# Autodesk Inventor assembly: mate-sub-pin
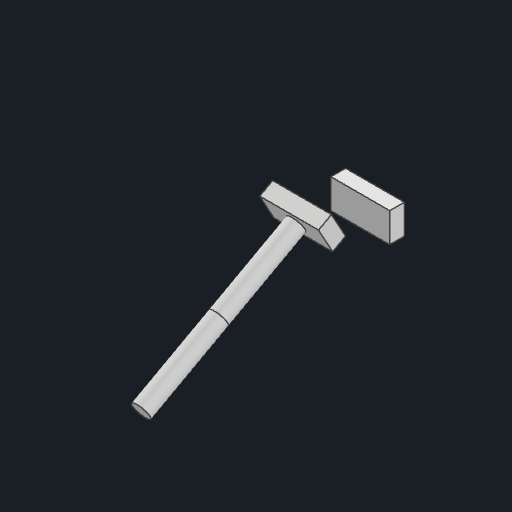
[picture p0: Inventor's stored thumbnail of the model, 512x512]
Saved by Autodesk Inventor 2026.1 (Build 301233000, 233)
## iProperties
Created: 2026-10-30
Part Number: mate-sub-pin
Document SubType Name: Assembly
Designer: david
Author: anony
## Documents named in this file (4)
- C:\Users\anony\OneDrive\Desktop\AI Projects\CAD Convert\corpus\generated\asm\mate-sub-pin.iam
- C:\Users\anony\OneDrive\Desktop\AI Projects\CAD Convert\corpus\generated\asmparts\box.ipt
- C:\Users\anony\OneDrive\Desktop\AI Projects\CAD Convert\corpus\generated\asmsub\sub.iam
- C:\Users\anony\OneDrive\Desktop\AI Projects\CAD Convert\corpus\generated\asmparts\pin.ipt
## Components (3 placed, 3 different names)
1. box:1
2. sub:1 [sub-assembly] — Insert:1
3. pin:1 — Insert:1
## Relationships (1: Insert 1)
- Insert:1: sub:1 ↔ pin:1
